# Autodesk Inventor assembly: Uretrak_pt1
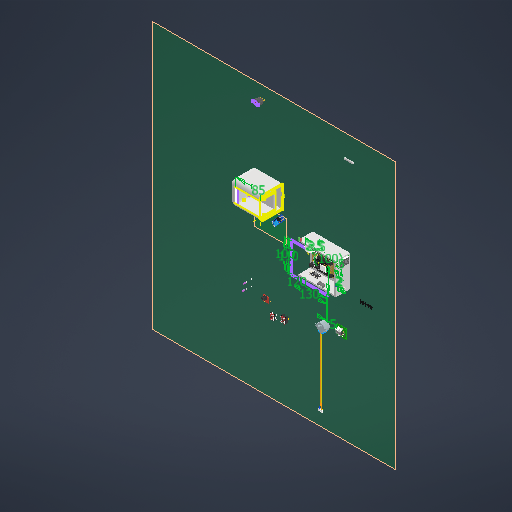
[picture p0: Inventor's stored thumbnail of the model, 512x512]
Saved by Autodesk Inventor 2026.2 (Build 302298000, 298)
## iProperties
Created: 2026-10-27
Part Number: Uretrak_pt1
Document SubType Name: Assembly
Designer: Usuario
Author: Usuario
## Documents named in this file (28)
- C:\Users\Usuario\Downloads\Uretrak_pt1.iam
- C:\Users\Usuario\Downloads\catéter (1) (1).ipt
- C:\Users\Usuario\Downloads\piezas\LED DE 5MM\LED DE 5MM\LED DE 5MM.ipt
- C:\Users\Usuario\Downloads\piezas\LED DE 5MM\A4988-Stepper-Driver-Socketed\A4988-Stepper-Driver-Socketed.ipt
- C:\Users\Usuario\Downloads\piezas\LED DE 5MM\A4988-Stepper-Driver-WithPins\A4988-Stepper-Driver-WithPins.ipt
- C:\Users\Usuario\Downloads\otras piezas\INA219 GY219\INA219 GY219\INA219 GY219.ipt
- C:\Users\Usuario\Downloads\piezas 5\28BYJ-48_uln2003_assy\conn-male 1x17\conn-male 1x17.ipt
- C:\Users\Usuario\Downloads\piezas 5\28BYJ-48_uln2003_assy\conn-male 1x17.ipt
- C:\Users\Usuario\Downloads\piezas 5\28BYJ-48_uln2003_assy\header_2.54_female\header_2.54_female.ipt
- C:\Users\Usuario\Downloads\piezas 5\28BYJ-48_uln2003_assy\IP2326_balance_charger(LX-LISC)\IP2326_balance_charger(LX-LISC).ipt
- C:\Users\Usuario\Downloads\piezas 5\28BYJ-48_uln2003_assy\MT3608-Module_762\MT3608-Module_762.ipt
- C:\Users\Usuario\Downloads\piezas 5\28BYJ-48_uln2003_assy\Shield ESP32\Shield ESP32.ipt
- C:\Users\Usuario\Downloads\piezas 5\28BYJ-48_uln2003_assy\TP4056_Charging_Module_Type_C\TP4056_Charging_Module_Type_C.ipt
- C:\Users\Usuario\Downloads\piezas 5\28BYJ-48_uln2003_assy\Fuse 70-059-60 v2\Fuse 70-059-60 v2.ipt
- C:\Users\Usuario\Downloads\piezas 2\Battery Level Indicator Module 1S-8S\STP\Battery Level Indicator Module 1S-8S\Battery Level Indicator Module 1S-8S\Battery Level Indicator Module 1S-8S.ipt
- C:\Users\Usuario\Downloads\piezas 2\Fuse holder PCB 5x20\Fuse holder PCB 5x20\Fuse holder PCB 5x20\Fuse holder PCB 5x20.ipt
- C:\Users\Usuario\Downloads\piezas 3\APEM Series 5000 Toggle Switch (5649agbx408 - 5000 PCB)\APEM Series 5000 Toggle Switch (5649agbx408 - 5000 PCB)\APEM Series 5000 Toggle Switch (5649agbx408 - 5000 PCB).ipt
- C:\Users\Usuario\Downloads\piezas 3\5mm_LED_Green-0\5mm_LED_Green-0\5mm_LED_Green-0.ipt
- C:\Users\Usuario\Downloads\piezas 3\5mm_LED_Red-0\5mm_LED_Red-0\5mm_LED_Red-0.ipt
- C:\Users\Usuario\Downloads\piezas 3\Mechanical_Endstop_rev2\Mechanical_Endstop_rev2\Mechanical_Endstop_rev2.ipt
- C:\Users\Usuario\Downloads\piezas 3\Bateria_litio_523450\Litio_523450\Litio_523450\Litio_523450.ipt
- C:\Users\Usuario\Downloads\piezas 4\Oval Stop Butonu\Oval Stop Butonu\Oval Stop Butonu.ipt
- C:\Users\Usuario\Downloads\piezas 4\Perfboards Config\Perfboards Config\Perfboards Config.ipt
- C:\Users\Usuario\Downloads\piezas 5\28BYJ-48_uln2003_assy\28BYJ-48_uln2003_assy\28BYJ-48_uln2003_assy.ipt
- C:\Users\Usuario\Downloads\piezas 5\Part1\Part1\Part1.ipt
- C:\Users\Usuario\Downloads\piezas 5\Part1\ULN2003 Stepper Driver.ipt
- C:\Users\Usuario\Downloads\base.ipt
- C:\Users\Usuario\Downloads\Pieza9.ipt
## Components (31 placed, 26 different names)
1. catéter (1) (1):1 — Coincidencia:1, Coincidencia:2
2. LED DE 5MM:1
3. LED DE 5MM:2
4. A4988-Stepper-Driver-Socketed:1
5. A4988-Stepper-Driver-WithPins:1
6. INA219 GY219:1
7. conn-male 1x17:1 — Coincidencia:11
8. conn-male 1x17:2 — Coincidencia:10
9. header_2.54_female:1 — Coincidencia:9
10. IP2326_balance_charger(LX-LISC):1 — Coincidencia:7
11. MT3608-Module_762:1
12. MT3608-Module_762:2 — Coincidencia:3
13. Shield ESP32:1
14. TP4056_Charging_Module_Type_C:1 — Coincidencia:6
15. Fuse 70-059-60 v2:1
16. conn-male 1x17:3
17. Battery Level Indicator Module 1S-8S:1 — Rígido:9
18. Fuse holder PCB 5x20:1 — Coincidencia:5
19. APEM Series 5000 Toggle Switch (5649agbx408 - 5000 PCB):1 — Coincidencia:8
20. 5mm_LED_Green-0:1 — Coincidencia:13
21. 5mm_LED_Red-0:1 — Coincidencia:12
22. Mechanical_Endstop_rev2:1 — Rígido:10, Coincidencia:14
23. Litio_523450:1 — Rígido:7
24. Oval Stop Butonu:1
25. Perfboards Config:1 — Rígido:8, Coincidencia:6
26. Perfboards Config:2 — Rígido:8, Coincidencia:3, Coincidencia:10, Coincidencia:11
27. 28BYJ-48_uln2003_assy:1
28. Part1:1 — Coincidencia:4, Nivelación:1, Nivelación:2
29. ULN2003 Stepper Driver:1
30. base:1 — Rígido:7, Rígido:9, Coincidencia:4, Coincidencia:5, Coincidencia:7, Rígido:10, Coincidencia:8, Coincidencia:9, Coincidencia:12, Coincidencia:13, Coincidencia:14
31. Pieza9:1 — Nivelación:1, Nivelación:2
## Relationships (20: Mate 14, WeldJoint 4, Flush 2)
- Coincidencia:1 [Mate]: catéter (1) (1):1
- Coincidencia:2 [Mate]: catéter (1) (1):1
- Rígido:7 [WeldJoint]: Litio_523450:1 ↔ base:1
- Rígido:8 [WeldJoint]: Perfboards Config:1 ↔ Perfboards Config:2
- Rígido:9 [WeldJoint]: Battery Level Indicator Module 1S-8S:1 ↔ base:1
- Coincidencia:3 [Mate]: MT3608-Module_762:2 ↔ Perfboards Config:2
- Coincidencia:4 [Mate]: Part1:1 ↔ base:1
- Coincidencia:5 [Mate]: Fuse holder PCB 5x20:1 ↔ base:1
- Coincidencia:6 [Mate]: TP4056_Charging_Module_Type_C:1 ↔ Perfboards Config:1
- Coincidencia:7 [Mate]: IP2326_balance_charger(LX-LISC):1 ↔ base:1
- Rígido:10 [WeldJoint]: Mechanical_Endstop_rev2:1 ↔ base:1
- Coincidencia:8 [Mate]: APEM Series 5000 Toggle Switch (5649agbx408 - 5000 PCB):1 ↔ base:1
- Coincidencia:9 [Mate]: header_2.54_female:1 ↔ base:1
- Coincidencia:10 [Mate]: conn-male 1x17:2 ↔ Perfboards Config:2
- Coincidencia:11 [Mate]: conn-male 1x17:1 ↔ Perfboards Config:2
- Coincidencia:12 [Mate]: 5mm_LED_Red-0:1 ↔ base:1
- Coincidencia:13 [Mate]: 5mm_LED_Green-0:1 ↔ base:1
- Nivelación:1 [Flush]: Part1:1 ↔ Pieza9:1
- Nivelación:2 [Flush]: Part1:1 ↔ Pieza9:1
- Coincidencia:14 [Mate]: Mechanical_Endstop_rev2:1 ↔ base:1
